# Autodesk Inventor assembly: GR Master
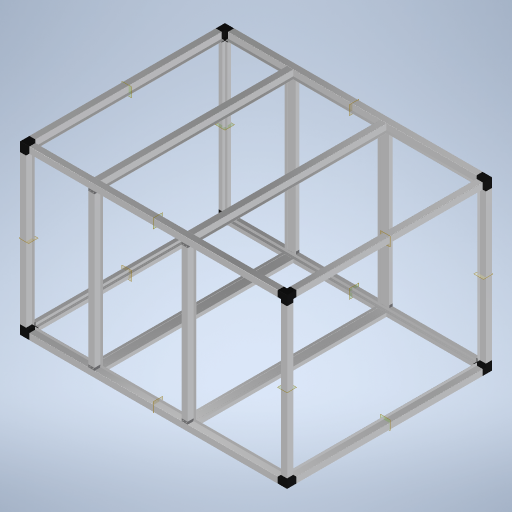
[picture p0: Inventor's stored thumbnail of the model, 512x512]
Saved by Autodesk Inventor 2024.4 (Build 284460030, 460C)
## iProperties
Created: 2026-11-19
Part Number: GR Master
Material: Generisch
Document SubType Name: Assembly
Designer: Loay Azzeh
Mass: 33970.5 g
Surface Area: 150383 cm^2
Volume: 13331 cm^3
Density: 2.54824 g/cm^3
Author: Loay Azzeh
## Documents named in this file (8)
- C:\Users\ahmad\OneDrive\Desktop\Inventor_Sizer\C# Version\GR\trail4.iam
- C:\Users\ahmad\OneDrive\Desktop\Inventor_Sizer\APS Ecke Kunststoff.ipt
- C:\Users\ahmad\OneDrive\Desktop\Inventor_Sizer\Joint.ipt
- C:\Users\ahmad\OneDrive\Desktop\Inventor_Sizer\P150 2000mm.ipt
- C:\Users\ahmad\OneDrive\Desktop\Inventor_Sizer\P150 1200mm.ipt
- C:\Users\ahmad\OneDrive\Desktop\Inventor_Sizer\P150 1500mm.ipt
- C:\Users\ahmad\OneDrive\Desktop\Inventor_Sizer\P350 1210mm.ipt
- C:\Users\ahmad\OneDrive\Desktop\Inventor_Sizer\P350 1550mm gefräst.ipt
## Components (36 placed, 7 different names)
1. APS Ecke Kunststoff:1 — Mate:1, Flush:1, Flush:2, Mate:2, Flush:3, Flush:4, Flush:5, Flush:6, Mate:3
2. Joint:1 — Mate:20, Flush:49, Flush:50, Flush:51
3. P150 2000mm:1 — Mate:1, Flush:1, Flush:2, Mate:7, Flush:13, Flush:14, Flush:70, Mate:35, Flush:77, Flush:79, Mate:36
4. P350 1550mm gefräst:1 — Mate:34, Flush:75, Flush:76
5. P350 1210mm:1 — Mate:20, Flush:49, Flush:50, Flush:51, Mate:21, Flush:52, Flush:53, Flush:54, Mate:23, Mate:31, Flush:74, Flush:76, Flush:78
6. P150 1200mm:1 — Mate:2, Flush:3, Flush:4, Mate:23
7. P150 1500mm:1 — Flush:5, Flush:6, Mate:3, Flush:15, Flush:16, Mate:8
8. APS Ecke Kunststoff:2
9. P150 2000mm:2 — Flush:17, Flush:18, Mate:33
10. P150 1200mm:2
11. P150 1500mm:2 — Flush:19, Flush:20
12. APS Ecke Kunststoff:3 — Flush:15, Flush:16, Mate:8, Flush:17, Flush:18, Flush:47, Flush:48
13. APS Ecke Kunststoff:4 — Mate:7, Flush:13, Flush:14, Flush:19, Flush:20, Mate:19, Flush:45, Flush:46
14. APS Ecke Kunststoff:5
15. P150 2000mm:3 — Mate:32, Flush:71, Flush:73, Flush:75, Flush:82
16. P150 1200mm:3 — Flush:47, Flush:48
17. P150 1500mm:3
18. APS Ecke Kunststoff:6
19. P150 2000mm:4 — Mate:22, Flush:54, Mate:30, Mate:34, Mate:37
20. P150 1200mm:4 — Mate:19, Flush:45, Flush:46
21. P150 1500mm:4
22. APS Ecke Kunststoff:7
23. APS Ecke Kunststoff:8
24. Joint:2 — Mate:21, Flush:52, Flush:53, Mate:22
25. Joint:3
26. P350 1210mm:2 — Flush:70, Mate:31, Flush:72, Flush:80
27. Joint:4 — Mate:30
28. Joint:5
29. P350 1210mm:3 — Flush:73, Flush:74
30. Joint:6 — Mate:33
31. Joint:7
32. P350 1210mm:4 — Flush:71, Flush:72, Flush:81
33. Joint:8 — Mate:32
34. P350 1550mm gefräst:2 — Flush:81, Flush:82, Mate:37
35. P350 1550mm gefräst:3 — Mate:35, Flush:77, Flush:78
36. P350 1550mm gefräst:4 — Flush:79, Mate:36, Flush:80
## Relationships (116: Flush 80, Mate 36)
- Mate:1: APS Ecke Kunststoff:1 ↔ P150 2000mm:1
- Flush:1: APS Ecke Kunststoff:1 ↔ P150 2000mm:1
- Flush:2: APS Ecke Kunststoff:1 ↔ P150 2000mm:1
- Mate:2: APS Ecke Kunststoff:1 ↔ P150 1200mm:1
- Flush:3: APS Ecke Kunststoff:1 ↔ P150 1200mm:1
- Flush:4: APS Ecke Kunststoff:1 ↔ P150 1200mm:1
- Flush:5: APS Ecke Kunststoff:1 ↔ P150 1500mm:1
- Flush:6: APS Ecke Kunststoff:1 ↔ P150 1500mm:1
- Mate:3: APS Ecke Kunststoff:1 ↔ P150 1500mm:1
- [Mate]: APS Ecke Kunststoff:2 ↔ P150 2000mm:2
- [Flush]: APS Ecke Kunststoff:2 ↔ P150 2000mm:2
- [Flush]: APS Ecke Kunststoff:2 ↔ P150 2000mm:2
- [Mate]: APS Ecke Kunststoff:2 ↔ P150 1200mm:2
- [Flush]: APS Ecke Kunststoff:2 ↔ P150 1200mm:2
- [Flush]: APS Ecke Kunststoff:2 ↔ P150 1200mm:2
- [Flush]: APS Ecke Kunststoff:2 ↔ P150 1500mm:2
- [Flush]: APS Ecke Kunststoff:2 ↔ P150 1500mm:2
- [Mate]: APS Ecke Kunststoff:2 ↔ P150 1500mm:2
- Mate:7: P150 2000mm:1 ↔ APS Ecke Kunststoff:4
- Flush:13: P150 2000mm:1 ↔ APS Ecke Kunststoff:4
- Flush:14: P150 2000mm:1 ↔ APS Ecke Kunststoff:4
- Flush:15: P150 1500mm:1 ↔ APS Ecke Kunststoff:3
- Flush:16: P150 1500mm:1 ↔ APS Ecke Kunststoff:3
- Mate:8: P150 1500mm:1 ↔ APS Ecke Kunststoff:3
- Flush:17: P150 2000mm:2 ↔ APS Ecke Kunststoff:3
- Flush:18: P150 2000mm:2 ↔ APS Ecke Kunststoff:3
- Flush:19: P150 1500mm:2 ↔ APS Ecke Kunststoff:4
- Flush:20: P150 1500mm:2 ↔ APS Ecke Kunststoff:4
- [Mate]: APS Ecke Kunststoff:5 ↔ P150 2000mm:3
- [Flush]: APS Ecke Kunststoff:5 ↔ P150 2000mm:3
- [Flush]: APS Ecke Kunststoff:5 ↔ P150 2000mm:3
- [Mate]: APS Ecke Kunststoff:5 ↔ P150 1200mm:3
- [Flush]: APS Ecke Kunststoff:5 ↔ P150 1200mm:3
- [Flush]: APS Ecke Kunststoff:5 ↔ P150 1200mm:3
- [Flush]: APS Ecke Kunststoff:5 ↔ P150 1500mm:3
- [Flush]: APS Ecke Kunststoff:5 ↔ P150 1500mm:3
- [Mate]: APS Ecke Kunststoff:5 ↔ P150 1500mm:3
- [Mate]: APS Ecke Kunststoff:6 ↔ P150 2000mm:4
- [Flush]: APS Ecke Kunststoff:6 ↔ P150 2000mm:4
- [Flush]: APS Ecke Kunststoff:6 ↔ P150 2000mm:4
- [Mate]: APS Ecke Kunststoff:6 ↔ P150 1200mm:4
- [Flush]: APS Ecke Kunststoff:6 ↔ P150 1200mm:4
- [Flush]: APS Ecke Kunststoff:6 ↔ P150 1200mm:4
- [Flush]: APS Ecke Kunststoff:6 ↔ P150 1500mm:4
- [Flush]: APS Ecke Kunststoff:6 ↔ P150 1500mm:4
- [Mate]: APS Ecke Kunststoff:6 ↔ P150 1500mm:4
- [Mate]: P150 2000mm:3 ↔ APS Ecke Kunststoff:8
- [Flush]: P150 2000mm:3 ↔ APS Ecke Kunststoff:8
- [Flush]: P150 2000mm:3 ↔ APS Ecke Kunststoff:8
- [Flush]: P150 1500mm:3 ↔ APS Ecke Kunststoff:7
- [Flush]: P150 1500mm:3 ↔ APS Ecke Kunststoff:7
- [Mate]: P150 1500mm:3 ↔ APS Ecke Kunststoff:7
- [Mate]: P150 2000mm:4 ↔ APS Ecke Kunststoff:7
- [Flush]: P150 2000mm:4 ↔ APS Ecke Kunststoff:7
- [Flush]: P150 2000mm:4 ↔ APS Ecke Kunststoff:7
- [Flush]: P150 1500mm:4 ↔ APS Ecke Kunststoff:8
- [Flush]: P150 1500mm:4 ↔ APS Ecke Kunststoff:8
- [Flush]: APS Ecke Kunststoff:6 ↔ P150 1200mm:4
- [Flush]: APS Ecke Kunststoff:6 ↔ P150 1200mm:4
- Mate:19: APS Ecke Kunststoff:4 ↔ P150 1200mm:4
- Flush:45: APS Ecke Kunststoff:4 ↔ P150 1200mm:4
- Flush:46: APS Ecke Kunststoff:4 ↔ P150 1200mm:4
- Flush:47: APS Ecke Kunststoff:3 ↔ P150 1200mm:3
- Flush:48: APS Ecke Kunststoff:3 ↔ P150 1200mm:3
- Mate:20: Joint:1 ↔ P350 1210mm:1
- Flush:49: Joint:1 ↔ P350 1210mm:1
- Flush:50: Joint:1 ↔ P350 1210mm:1
- Flush:51: Joint:1 ↔ P350 1210mm:1
- Mate:21: P350 1210mm:1 ↔ Joint:2
- Flush:52: P350 1210mm:1 ↔ Joint:2
- Flush:53: P350 1210mm:1 ↔ Joint:2
- Mate:22: P150 2000mm:4 ↔ Joint:2
- Flush:54: P350 1210mm:1 ↔ P150 2000mm:4
- Mate:23 (500 mm): P350 1210mm:1 ↔ P150 1200mm:1
- [Mate]: Joint:3 ↔ P350 1210mm:2
- [Flush]: Joint:3 ↔ P350 1210mm:2
- [Flush]: Joint:3 ↔ P350 1210mm:2
- [Flush]: Joint:3 ↔ P350 1210mm:2
- [Mate]: P350 1210mm:2 ↔ Joint:4
- [Flush]: P350 1210mm:2 ↔ Joint:4
- [Flush]: P350 1210mm:2 ↔ Joint:4
- [Mate]: Joint:5 ↔ P350 1210mm:3
- [Flush]: Joint:5 ↔ P350 1210mm:3
- [Flush]: Joint:5 ↔ P350 1210mm:3
- [Flush]: Joint:5 ↔ P350 1210mm:3
- [Mate]: P350 1210mm:3 ↔ Joint:6
- [Flush]: P350 1210mm:3 ↔ Joint:6
- [Flush]: P350 1210mm:3 ↔ Joint:6
- [Mate]: Joint:7 ↔ P350 1210mm:4
- [Flush]: Joint:7 ↔ P350 1210mm:4
- [Flush]: Joint:7 ↔ P350 1210mm:4
- [Flush]: Joint:7 ↔ P350 1210mm:4
- [Mate]: P350 1210mm:4 ↔ Joint:8
- [Flush]: P350 1210mm:4 ↔ Joint:8
- [Flush]: P350 1210mm:4 ↔ Joint:8
- Mate:30: P150 2000mm:4 ↔ Joint:4
- Flush:70: P150 2000mm:1 ↔ P350 1210mm:2
- Mate:31 (700 mm): P350 1210mm:1 ↔ P350 1210mm:2
- Mate:32: P150 2000mm:3 ↔ Joint:8
- Flush:71: P150 2000mm:3 ↔ P350 1210mm:4
- Flush:72: P350 1210mm:2 ↔ P350 1210mm:4
- Flush:73: P150 2000mm:3 ↔ P350 1210mm:3
- Flush:74: P350 1210mm:1 ↔ P350 1210mm:3
- Mate:33: P150 2000mm:2 ↔ Joint:6
- Mate:34: P350 1550mm gefräst:1 ↔ P150 2000mm:4
- Flush:75: P350 1550mm gefräst:1 ↔ P150 2000mm:3
- Flush:76: P350 1550mm gefräst:1 ↔ P350 1210mm:1
- Mate:35: P150 2000mm:1 ↔ P350 1550mm gefräst:3
- Flush:77: P150 2000mm:1 ↔ P350 1550mm gefräst:3
- Flush:78: P350 1210mm:1 ↔ P350 1550mm gefräst:3
- Flush:79: P150 2000mm:1 ↔ P350 1550mm gefräst:4
- Mate:36: P150 2000mm:1 ↔ P350 1550mm gefräst:4
- Flush:80: P350 1210mm:2 ↔ P350 1550mm gefräst:4
- Flush:81: P350 1210mm:4 ↔ P350 1550mm gefräst:2
- Flush:82: P150 2000mm:3 ↔ P350 1550mm gefräst:2
- Mate:37: P150 2000mm:4 ↔ P350 1550mm gefräst:2
## Named parameters: d11_d0 = 0 mm, d12_d3 = 0 mm, d13_d4 = 0 mm, d14_d5 = 0 mm, d15_d6 = 0 mm, d16_d7 = 0 mm, d17_d8 = 0 mm, d18_d9 = 0 mm, d19_d10 = 0 mm, d33_d0 = 0 mm, d34_d3 = 0 mm, d35_d4 = 0 mm, d36_d5 = 0 mm, d37_d6 = 0 mm, d38_d7 = 0 mm, d39_d8 = 0 mm, d40_d9 = 0 mm, d41_d10 = 0 mm, d42_d11_d0 = 0 mm, d43_d12_d3 = 0 mm, d44_d13_d4 = 0 mm, d45_d14_d5 = 0 mm, d46_d15_d6 = 0 mm, d47_d16_d7 = 0 mm, d48_d17_d8 = 0 mm, d49_d18_d9 = 0 mm, d50_d19_d10 = 0 mm, d51_d20 = 0 mm, d52_d21 = 0 mm, d53_d22 = 0 mm, d54_d23 = 0 mm, d55_d24 = 0 mm, d56_d25 = 0 mm, d57_d26 = 0 mm, d58_d27 = 0 mm, d59_d28 = 0 mm, d60_d29 = 0 mm, d61_d30 = 0 mm, d62_d31 = 0 mm, d63_d32 = 0 mm, d79_d69 = 0 mm, d80_d70 = 0 mm, d81_d71 = 0 mm, d82_d72 = 0 mm, d83_d73 = 0 mm, d84_d74 = 0 mm, d85_d75 = 0 mm, d86_d69 = 0 mm, d87_d70 = 0 mm, d88_d71 = 0 mm, d89_d72 = 0 mm, d90_d73 = 0 mm, d91_d74 = 0 mm, d92_d75 = 0 mm, d93_d69 = 0 mm, d94_d70 = 0 mm, d95_d71 = 0 mm, d96_d72 = 0 mm, d97_d73 = 0 mm, d98_d74 = 0 mm, d99_d75 = 0 mm
